# Autodesk Inventor assembly: MM0948AN190_G10_001
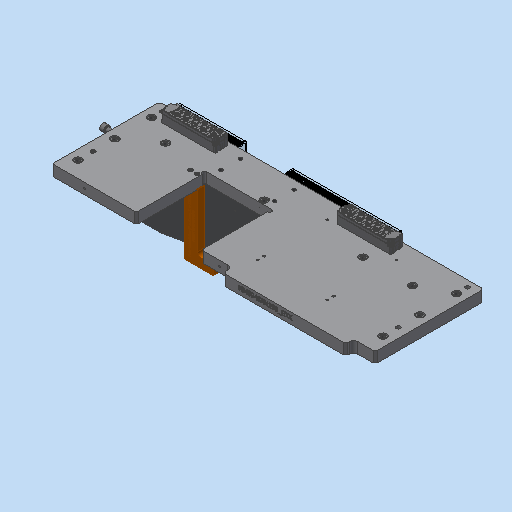
[picture p0: Inventor's stored thumbnail of the model, 512x512]
Saved by Autodesk Inventor 2023.3 (Build 273359000, 359)
## iProperties
Part Number: MM0948AN190_G10_001
Material: Generisch
Description: =<RBPARTNOTITLE2>
Document SubType Name: Assembly
Designer: FH/Wi
Mass: 43047.5 g
Surface Area: 6293.43 cm^2
Volume: 5552.9 cm^3
Density: 7.75225 g/cm^3
Project: 0850
Created: 2023-03-23
RBCHANGEDESCRIPTION1: Erstfreigabe
RBCHANGENO1: 00
RBDOCUMENTTYPE: DRF
RBDOCUMENTVERSION: 00
RBDRAWINGMAINSCALE: 1:1
RBDRAWINGMISSINGSPEC: --
RBDRAWINGVOLUME: --
RBDSV1: 0850
RBGBDETAILS: 43274
RBGBEDGESIN1: +0,5
RBGBEDGESIN2: +0,2
RBGBEDGESOUT1: -0,3
RBGBEDGESOUT2: -0,1
RBMATERIAL: =<Material>
RBMATMEETS: --
RBMATNO: =<Part Number>
RBORGUNITRESPONSIBLE1: AnP/TEF1
RBPARTMADEOF: --
RBPARTNO: SIEHE MNR
RBPARTNOTITLE1: connection plate Hupo 750
RBPARTNOTITLE2: Verbindungsplatte Hupo 750
RBPARTSAFETYINDICATOR: --
RBSURFACE: --
RBSURFACE2: --
RBZEDGESNORM: ISO13715:2002-06
RBZGENDIMCLASS: m
RBZGENDIMNORM: ISO 2768-1:1989-11
RBZGENGEOCLASS: H
RBZGENGEONORM: ISO 2768-2:1989-11
RBZSURFACENORM: ISO13D2:2002-02
RBZTOLERANCENORM: ISO 14405-1:2010-12
AnP_Kommentar: --
MaxAbmaße: --
AnP_TemplVers: 20190222
AnP_Kategorie: 99
AnP_Material: =<Material>
Name: MM0937AN110_G25_001.iam
Author: FH/Wi
Keywords: =<RBPARTMADEOF>
Comments: =<RBSURFACE2>
Revision Number: 01
## Documents named in this file (13)
- C:\Users\rea9an\Documents\Inventor\TCAI2412_te1910_EM\AS00000971.iam
- C:\Users\rea9an\Documents\Inventor\TCAI2412_te1910_EM\PT00004847.ipt
- C:\Users\rea9an\Documents\Inventor\TCAI2412_te1910_EM\PT00004717.ipt
- C:\Users\rea9an\Documents\Inventor\TCAI2412_te1910_EM\PT00004851.ipt
- C:\Users\rea9an\Documents\Inventor\TCAI2412_te1910_EM\PT00004848.ipt
- C:\Users\rea9an\Documents\Inventor\TCAI2412_te1910_EM\PT00004366.ipt
- C:\Users\rea9an\Documents\Inventor\TCAI2412_te1910_EM\PT00004540.ipt
- C:\Users\rea9an\Documents\Inventor\TCAI2412_te1910_EM\PT00004541.ipt
- C:\Users\rea9an\Documents\Inventor\TCAI2412_te1910_EM\PT00004860.ipt
- C:\Users\rea9an\Documents\Inventor\TCAI2412_te1910_EM\PT00004905.ipt
- C:\Users\rea9an\Documents\Inventor\TCAI2412_te1910_EM\PT00004718.ipt
- C:\Users\rea9an\Documents\Inventor\TCAI2412_te1910_EM\PT00004545.ipt
- C:\Users\rea9an\Documents\Inventor\TCAI2412_te1910_EM\PT00004883.ipt
## Components (28 placed, 12 different names)
1. PT00004883:1 — Einfügen:34
2. PT00004883:2 — Einfügen:35
3. PT00004545:1 — Einfügen:33, Passend:7
4. PT00004717:1 — Fluchtend:1, Fluchtend:2, Fluchtend:3, Einfügen:1, Einfügen:2, Einfügen:3, Einfügen:4, Einfügen:5, Einfügen:6, Einfügen:7, Einfügen:8, Einfügen:9, Passend:1, Einfügen:13, Einfügen:14, Einfügen:15, Einfügen:16, Einfügen:25, Einfügen:26, Einfügen:27, Einfügen:28, Passend:3, Fluchtend:6, Passend:5, Fluchtend:7, Einfügen:29, Einfügen:30, Einfügen:31, Einfügen:32, Einfügen:33, Passend:7, Einfügen:34, Einfügen:35
5. PT00004718:1 — Einfügen:9, Passend:1, Einfügen:10, Einfügen:11, Einfügen:12
6. PT00004851:1 — Einfügen:10
7. PT00004848:1 — Einfügen:12
8. PT00004848:2 — Einfügen:11
9. PT00004848:3 — Einfügen:14
10. PT00004848:4 — Einfügen:13
11. PT00004848:5 — Einfügen:16
12. PT00004848:6 — Einfügen:15
13. PT00004905:1 — Einfügen:1
14. PT00004905:2 — Einfügen:2
15. PT00004847:1 — Einfügen:3
16. PT00004847:2 — Einfügen:4
17. PT00004847:3 — Einfügen:5
18. PT00004847:4 — Einfügen:8
19. PT00004847:5 — Einfügen:7
20. PT00004847:6 — Einfügen:6
21. PT00004860:1 — Einfügen:29
22. PT00004860:2 — Einfügen:30
23. PT00004860:3 — Einfügen:31
24. PT00004860:4 — Einfügen:32
25. PT00004366:1 — Einfügen:25, Einfügen:26
26. PT00004366:2 — Einfügen:27, Einfügen:28
27. PT00004540:1 — Passend:3, Fluchtend:6, Passend:6
28. PT00004541:1 — Passend:5, Fluchtend:7, Passend:6
## Relationships (37: Insert 27, Flush 5, Mate 5)
- Fluchtend:1 [Flush]: PT00004717:1
- Fluchtend:2 [Flush] (1327 mm): PT00004717:1
- Fluchtend:3 [Flush] (-758 mm): PT00004717:1
- Einfügen:1 [Insert]: PT00004717:1 ↔ PT00004905:1
- Einfügen:2 [Insert]: PT00004717:1 ↔ PT00004905:2
- Einfügen:3 [Insert]: PT00004717:1 ↔ PT00004847:1
- Einfügen:4 [Insert]: PT00004717:1 ↔ PT00004847:2
- Einfügen:5 [Insert]: PT00004717:1 ↔ PT00004847:3
- Einfügen:6 [Insert]: PT00004717:1 ↔ PT00004847:6
- Einfügen:7 [Insert]: PT00004717:1 ↔ PT00004847:5
- Einfügen:8 [Insert]: PT00004717:1 ↔ PT00004847:4
- Einfügen:9 [Insert]: PT00004717:1 ↔ PT00004718:1
- Passend:1 [Mate]: PT00004717:1 ↔ PT00004718:1
- Einfügen:10 [Insert] (75 mm): PT00004718:1 ↔ PT00004851:1
- Einfügen:11 [Insert] (13 mm): PT00004718:1 ↔ PT00004848:2
- Einfügen:12 [Insert] (13 mm): PT00004718:1 ↔ PT00004848:1
- Einfügen:13 [Insert]: PT00004717:1 ↔ PT00004848:4
- Einfügen:14 [Insert]: PT00004717:1 ↔ PT00004848:3
- Einfügen:15 [Insert]: PT00004717:1 ↔ PT00004848:6
- Einfügen:16 [Insert]: PT00004717:1 ↔ PT00004848:5
- Einfügen:25 [Insert]: PT00004717:1 ↔ PT00004366:1
- Einfügen:26 [Insert]: PT00004717:1 ↔ PT00004366:1
- Einfügen:27 [Insert]: PT00004717:1 ↔ PT00004366:2
- Einfügen:28 [Insert]: PT00004717:1 ↔ PT00004366:2
- Passend:3 [Mate]: PT00004717:1 ↔ PT00004540:1
- Fluchtend:6 [Flush] (12.5 mm): PT00004717:1 ↔ PT00004540:1
- Passend:5 [Mate]: PT00004717:1 ↔ PT00004541:1
- Fluchtend:7 [Flush] (12.5 mm): PT00004717:1 ↔ PT00004541:1
- Einfügen:29 [Insert] (13.5 mm): PT00004717:1 ↔ PT00004860:1
- Einfügen:30 [Insert] (14 mm): PT00004717:1 ↔ PT00004860:2
- Einfügen:31 [Insert] (14 mm): PT00004717:1 ↔ PT00004860:3
- Einfügen:32 [Insert] (13.5 mm): PT00004717:1 ↔ PT00004860:4
- Passend:6 [Mate] (110 mm): PT00004540:1 ↔ PT00004541:1
- Einfügen:33 [Insert]: PT00004545:1 ↔ PT00004717:1
- Passend:7 [Mate]: PT00004545:1 ↔ PT00004717:1
- Einfügen:34 [Insert]: PT00004883:1 ↔ PT00004717:1
- Einfügen:35 [Insert]: PT00004883:2 ↔ PT00004717:1
